# Autodesk Inventor assembly: Prototype_ASM
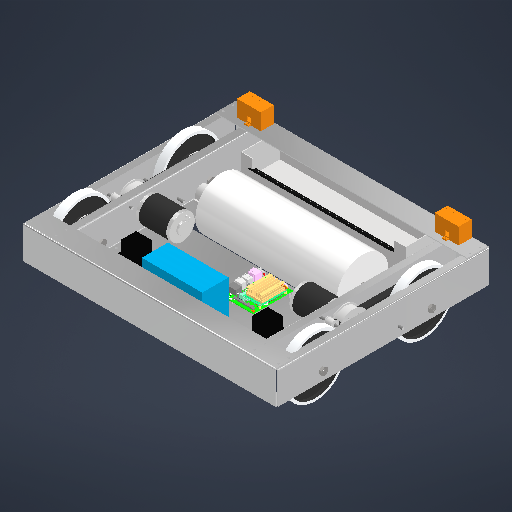
[picture p0: Inventor's stored thumbnail of the model, 512x512]
Saved by Autodesk Inventor 2026.2 (Build 302298010, 298A)
## iProperties
Created: 2026-10-11
Part Number: Prototype_ASM
Document SubType Name: Assembly
Designer: User
Author: User
## Documents named in this file (29)
- D:\Autodesk Invento Pro Work\Honours Project\Parts\Prototype_ASM.iam
- D:\Autodesk Invento Pro Work\Honours Project\Parts\C_Bend.ipt
- D:\Autodesk Invento Pro Work\Honours Project\Parts\L_Bend.ipt
- D:\Autodesk Invento Pro Work\Honours Project\Parts\S_Bend.ipt
- D:\Autodesk Invento Pro Work\Honours Project\Parts\S_Bend_MIR1.ipt
- D:\Autodesk Invento Pro Work\Honours Project\Parts\L_Bend_MIR.ipt
- D:\Autodesk Invento Pro Work\Honours Project\Parts\Base Plate.ipt
- D:\Autodesk Invento Pro Work\Honours Project\Parts\Roller_Assembly.iam
- D:\Autodesk Invento Pro Work\Honours Project\Parts\Victor_888_Motor_Driver.ipt
- D:\Autodesk Invento Pro Work\Honours Project\Parts\Container_ASM.iam
- D:\Autodesk Invento Pro Work\Honours Project\Parts\Plastic peg.ipt
- D:\Autodesk Invento Pro Work\Honours Project\Parts\Jetson_Nano_Dev_Kit_3D_b01.iam
- C:\Users\User\Documents\Inventor\Content Center Files\R2026\en-US\BS EN ISO 4014\BS EN ISO 4014 - M10 x 90.ipt
- C:\Users\User\Documents\Inventor\Content Center Files\R2026\en-US\AS 1112 (4)\AS 1112 - M10(2).ipt
- D:\Autodesk Invento Pro Work\Honours Project\Parts\217-3371-STEP.ipt
- D:\Autodesk Invento Pro Work\Honours Project\Parts\Shaft Key.ipt
- D:\Autodesk Invento Pro Work\Honours Project\Parts\Pulley Insert.ipt
- D:\Autodesk Invento Pro Work\Honours Project\Parts\Pulley.ipt
- D:\Autodesk Invento Pro Work\Honours Project\Parts\Motor End Cap.ipt
- D:\Autodesk Invento Pro Work\Honours Project\Parts\Spacer.ipt
- D:\Autodesk Invento Pro Work\Honours Project\Parts\Wheel_Axel.ipt
- D:\Autodesk Invento Pro Work\Honours Project\Parts\Wheel.ipt
- D:\Autodesk Invento Pro Work\Honours Project\Parts\Timing Belt (model only).ipt
- D:\Autodesk Invento Pro Work\Honours Project\Parts\110mm threaded rod.ipt
- D:\Autodesk Invento Pro Work\Honours Project\Parts\60mm threaded rod.ipt
- D:\Autodesk Invento Pro Work\Honours Project\Parts\Tensioner.ipt
- D:\Autodesk Invento Pro Work\Honours Project\Parts\Tensioner (thicker).ipt
- D:\Autodesk Invento Pro Work\Honours Project\Parts\US_ASM.iam
- D:\Autodesk Invento Pro Work\Honours Project\Parts\Battery.ipt
## Components (59 placed, 28 different names)
1. C_Bend:1 — Mate:5
2. C_Bend:2 — Mate:1, Mate:2, Mate:3, Mate:4, Mate:58, Mate:59
3. L_Bend:1 — Mate:2, Mate:22, Mate:23
4. S_Bend:1 — Mate:1, Mate:5, Mate:6, Slider:2, Mate:16, Mate:17, Mate:25, Mate:34, Mate:35, Mate:52, Mate:53
5. S_Bend_MIR1:1 — Mate:3, Mate:18, Mate:19, Mate:24, Mate:36, Mate:37, Rotational:1, Rotational:2, Mate:54, Mate:55
6. L_Bend_MIR:1 — Mate:4, Mate:20, Mate:21
7. Base Plate:1 — Mate:6, Mate:7, Mate:8, Mate:9, Mate:10, Mate:11, Mate:12, Mate:13, Mate:14, Rigid:1
8. Roller_Assembly:1 [sub-assembly] — Mate:7, Mate:8
9. Victor_888_Motor_Driver:1 — Mate:9
10. Victor_888_Motor_Driver:2 — Mate:10
11. Container_ASM:1 [sub-assembly] — Slider:2
12. Plastic peg:1 — Mate:11, Mate:15
13. Plastic peg:2 — Mate:12
14. Plastic peg:3 — Mate:13
15. Plastic peg:4 — Mate:14
16. Jetson_Nano_Dev_Kit_3D_b01:1 [sub-assembly] — Mate:15
17. BS EN ISO 4014 M10 x 90:1 — Mate:17
18. BS EN ISO 4014 M10 x 90:2 — Mate:16
19. BS EN ISO 4014 M10 x 90:3 — Mate:18
20. BS EN ISO 4014 M10 x 90:4 — Mate:19
21. AS 1112 (4) - Metric M10:1 — Mate:21
22. AS 1112 (4) - Metric M10:2 — Mate:22
23. AS 1112 (4) - Metric M10:3 — Mate:20
24. AS 1112 (4) - Metric M10:4 — Mate:23
25. 217-3371-STEP:1 — Mate:24, Mate:27, Mate:29
26. 217-3371-STEP:2 — Mate:25, Mate:26, Mate:28
27. Shaft Key:1 — Mate:26
28. Shaft Key:2 — Mate:27
29. Pulley Insert:1 — Mate:29, Mate:43, Mate:44
30. Pulley Insert:2 — Mate:28, Mate:30
31. Pulley:1 — Mate:30, Mate:42
32. Pulley:2 — Mate:43
33. Motor End Cap:1 — Mate:44
34. Motor End Cap:2 — Mate:42
35. Spacer:1 — Mate:36, Mate:39
36. Spacer:2 — Mate:34, Mate:41
37. Spacer:3 — Mate:37, Mate:38
38. Spacer:4 — Mate:35, Mate:40
39. Wheel_Axel:1 — Mate:39, Mate:48
40. Wheel_Axel:2 — Mate:38, Mate:47, Mate:49
41. Wheel_Axel:3 — Mate:41, Mate:46, Mate:50
42. Wheel_Axel:4 — Mate:40, Mate:45
43. Wheel:1 — Mate:45
44. Wheel:2 — Mate:46
45. Wheel:3 — Mate:47
46. Wheel:4 — Mate:48
47. Timing Belt (model only):1 — Mate:49
48. Timing Belt (model only):2 — Mate:50
49. 110mm threaded rod:1 — Mate:53, Mate:56
50. 110mm threaded rod:2 — Rotational:2
51. 60mm threaded rod:1 — Mate:52, Mate:57
52. 60mm threaded rod:2 — Rotational:1
53. Tensioner:1 — Mate:54
54. Tensioner:2 — Mate:56
55. Tensioner (thicker):1 — Mate:57
56. Tensioner (thicker):2 — Mate:55
57. US_ASM:1 [sub-assembly] — Mate:58
58. US_ASM:2 [sub-assembly] — Mate:59
59. Battery:1 — Rigid:1
## Relationships (59: Mate 55, RevoluteJoint 2, TranslationJoint 1, WeldJoint 1)
- Mate:1: C_Bend:2 ↔ S_Bend:1
- Mate:2: C_Bend:2 ↔ L_Bend:1
- Mate:3: C_Bend:2 ↔ S_Bend_MIR1:1
- Mate:4: C_Bend:2 ↔ L_Bend_MIR:1
- Mate:5: C_Bend:1 ↔ S_Bend:1
- Mate:6: S_Bend:1 ↔ Base Plate:1
- Mate:7: Base Plate:1 ↔ Roller_Assembly:1
- Mate:8: Base Plate:1 ↔ Roller_Assembly:1
- Mate:9: Base Plate:1 ↔ Victor_888_Motor_Driver:1
- Mate:10: Base Plate:1 ↔ Victor_888_Motor_Driver:2
- Slider:2 [TranslationJoint] (28.404 mm): S_Bend:1 ↔ Container_ASM:1
- Mate:11: Base Plate:1 ↔ Plastic peg:1
- Mate:12: Base Plate:1 ↔ Plastic peg:2
- Mate:13: Base Plate:1 ↔ Plastic peg:3
- Mate:14: Base Plate:1 ↔ Plastic peg:4
- Mate:15: Plastic peg:1 ↔ Jetson_Nano_Dev_Kit_3D_b01:1
- Mate:16: S_Bend:1 ↔ BS EN ISO 4014 M10 x 90:2
- Mate:17: S_Bend:1 ↔ BS EN ISO 4014 M10 x 90:1
- Mate:18: S_Bend_MIR1:1 ↔ BS EN ISO 4014 M10 x 90:3
- Mate:19: S_Bend_MIR1:1 ↔ BS EN ISO 4014 M10 x 90:4
- Mate:20: L_Bend_MIR:1 ↔ AS 1112 (4) - Metric M10:3
- Mate:21: L_Bend_MIR:1 ↔ AS 1112 (4) - Metric M10:1
- Mate:22: L_Bend:1 ↔ AS 1112 (4) - Metric M10:2
- Mate:23: L_Bend:1 ↔ AS 1112 (4) - Metric M10:4
- Mate:24: S_Bend_MIR1:1 ↔ 217-3371-STEP:1
- Mate:25: S_Bend:1 ↔ 217-3371-STEP:2
- Mate:26: 217-3371-STEP:2 ↔ Shaft Key:1
- Mate:27: 217-3371-STEP:1 ↔ Shaft Key:2
- Mate:28: 217-3371-STEP:2 ↔ Pulley Insert:2
- Mate:29: 217-3371-STEP:1 ↔ Pulley Insert:1
- Mate:30 (13 mm): Pulley Insert:2 ↔ Pulley:1
- Mate:34: S_Bend:1 ↔ Spacer:2
- Mate:35: S_Bend:1 ↔ Spacer:4
- Mate:36: S_Bend_MIR1:1 ↔ Spacer:1
- Mate:37: S_Bend_MIR1:1 ↔ Spacer:3
- Mate:38: Spacer:3 ↔ Wheel_Axel:2
- Mate:39: Spacer:1 ↔ Wheel_Axel:1
- Mate:40: Spacer:4 ↔ Wheel_Axel:4
- Mate:41: Spacer:2 ↔ Wheel_Axel:3
- Mate:42: Pulley:1 ↔ Motor End Cap:2
- Mate:43 (17 mm): Pulley Insert:1 ↔ Pulley:2
- Mate:44: Pulley Insert:1 ↔ Motor End Cap:1
- Mate:45: Wheel_Axel:4 ↔ Wheel:1
- Mate:46: Wheel_Axel:3 ↔ Wheel:2
- Mate:47: Wheel_Axel:2 ↔ Wheel:3
- Mate:48: Wheel_Axel:1 ↔ Wheel:4
- Mate:49: Wheel_Axel:2 ↔ Timing Belt (model only):1
- Mate:50: Wheel_Axel:3 ↔ Timing Belt (model only):2
- Mate:52 (-5 mm): S_Bend:1 ↔ 60mm threaded rod:1
- Rotational:1 [RevoluteJoint] (5 mm): S_Bend_MIR1:1 ↔ 60mm threaded rod:2
- Mate:53 (15 mm): S_Bend:1 ↔ 110mm threaded rod:1
- Rotational:2 [RevoluteJoint] (15 mm): S_Bend_MIR1:1 ↔ 110mm threaded rod:2
- Mate:54 (22.5 mm): S_Bend_MIR1:1 ↔ Tensioner:1
- Mate:55 (22.5 mm): S_Bend_MIR1:1 ↔ Tensioner (thicker):2
- Mate:56 (70.5 mm): 110mm threaded rod:1 ↔ Tensioner:2
- Mate:57 (30.5 mm): 60mm threaded rod:1 ↔ Tensioner (thicker):1
- Mate:58: C_Bend:2 ↔ US_ASM:1
- Mate:59: C_Bend:2 ↔ US_ASM:2
- Rigid:1 [WeldJoint] (-120 mm): Base Plate:1 ↔ Battery:1
